# Autodesk Inventor assembly: BOARD
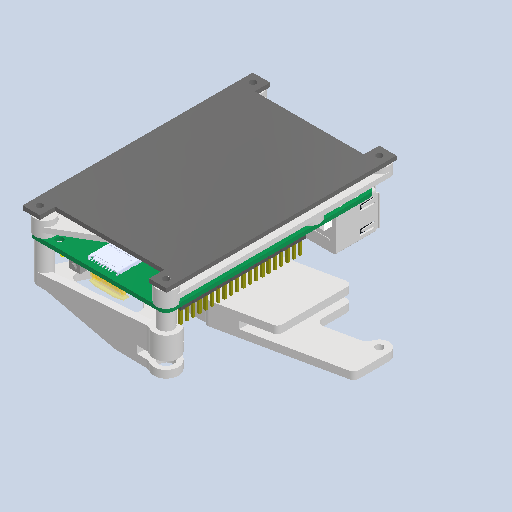
[picture p0: Inventor's stored thumbnail of the model, 512x512]
Saved by Autodesk Inventor 2025.3 (Build 293356000, 356)
## iProperties
Created: 2026-09-09
Part Number: BOARD
Document SubType Name: Assembly
Designer: shfzf
Author: shfzf
## Documents named in this file (6)
- C:\Users\shfzf\Desktop\FEIBOT\ROBOT_CAD\BOARD.iam
- C:\Users\shfzf\Desktop\FEIBOT\ROBOT_CAD\BOARD_SUPPORT.ipt
- C:\Users\shfzf\Desktop\FEIBOT\ROBOT_CAD\CHIWU.ipt
- C:\Users\shfzf\Desktop\FEIBOT\ROBOT_CAD\FAN_SUPPORT.ipt
- C:\Users\shfzf\Desktop\FEIBOT\ROBOT_CAD\raspberry_pi_5\raspberry_pi_5.iam
- C:\Users\shfzf\Desktop\FEIBOT\ROBOT_CAD\FAN.ipt
## Components (5 placed, 5 different names)
1. BOARD_SUPPORT:1 — 配合:1, 配合:2, 配合:3, 配合:4, 配合:5, 配合:6, 配合:7, 配合:8
2. CHIWU:1 — 配合:1, 配合:2, 配合:3, 配合:4
3. FAN_SUPPORT:1 — 配合:9, 配合:10, 配合:11, 配合:12, 配合:13
4. raspberry_pi_5:1 [sub-assembly] — 配合:5, 配合:6, 配合:7, 配合:8, 配合:9, 配合:10
5. FAN:1 — 配合:11, 配合:12, 配合:13
## Relationships (13: Mate 13)
- 配合:1 [Mate]: BOARD_SUPPORT:1 ↔ CHIWU:1
- 配合:2 [Mate]: BOARD_SUPPORT:1 ↔ CHIWU:1
- 配合:3 [Mate]: BOARD_SUPPORT:1 ↔ CHIWU:1
- 配合:4 [Mate]: BOARD_SUPPORT:1 ↔ CHIWU:1
- 配合:5 [Mate]: BOARD_SUPPORT:1 ↔ raspberry_pi_5:1
- 配合:6 [Mate]: BOARD_SUPPORT:1 ↔ raspberry_pi_5:1
- 配合:7 [Mate]: BOARD_SUPPORT:1 ↔ raspberry_pi_5:1
- 配合:8 [Mate]: BOARD_SUPPORT:1 ↔ raspberry_pi_5:1
- 配合:9 [Mate]: FAN_SUPPORT:1 ↔ raspberry_pi_5:1
- 配合:10 [Mate]: FAN_SUPPORT:1 ↔ raspberry_pi_5:1
- 配合:11 [Mate]: FAN_SUPPORT:1 ↔ FAN:1
- 配合:12 [Mate]: FAN_SUPPORT:1 ↔ FAN:1
- 配合:13 [Mate]: FAN_SUPPORT:1 ↔ FAN:1
